# Autodesk Inventor assembly: montagem roda omni (adaptada)
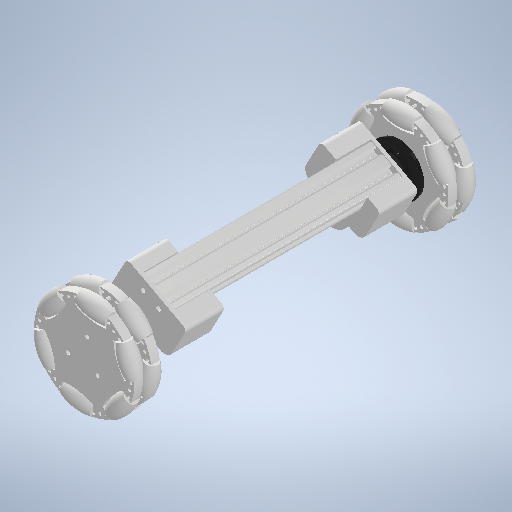
[picture p0: Inventor's stored thumbnail of the model, 512x512]
Saved by Autodesk Inventor 2025.2 (Build 292293000, 293)
## iProperties
Created: 2026-06-01
Part Number: montagem roda omni (adaptada)
Document SubType Name: Assembly
Designer: joaoc
Author: joaoc
## iProperties of the stored document Acoplamento motor roda V2.ipt
Created: 2025-01-07
Part Number: Acoplamento motor roda V2
Material: ABS Plastic
Document SubType Name: Modeling
Designer: Cliente
Mass: 17.616 g
Surface Area: 80.0658 cm^2
Volume: 19.1063 cm^3
Density: 0.922 g/cm^3
Appearance: Default
Sending System: Autodesk Inventor 2026
Author: Cliente
## iProperties of the stored document Mancal improvisado.ipt
Created: 2026-06-02
Part Number: Mancal improvisado
Material: Generic
Description: STEP AP203
Document SubType Name: Modeling
Designer: joaoc
Density: 1 g/cm^3
Appearance: Default
Sending System: SolidWorks 2023
Preprocessor: SwSTEP 2.0
Title: Mancal improvisado.STEP
Revision Number: ANY
## Documents named in this file (9)
- C:\Users\joaoc\Documents\montagem omnicare final\montagem roda omni (adaptada).iam
- C:\Users\joaoc\Documents\montagem omnicare final\Roda\roda 6.ipt
- **C:\Users\joaoc\Documents\montagem omnicare final\montagem roda omni (adaptada).iam*LocalDocs*xAaaaqadaAaaaaaaaAaaaaqfkYc*Acoplamento motor roda V2.ipt
- C:\Users\joaoc\Documents\montagem omnicare final\Perfil de alumínio\Perfil de alumínio.ipt
- C:\Users\joaoc\Documents\montagem omnicare final\rolamento\w_628_7_r-2z.iam
- **C:\Users\joaoc\Documents\montagem omnicare final\montagem roda omni (adaptada).iam*LocalDocs*xAaaaqedaAaaaaaaaAaaaq0lr5d*Mancal improvisado.ipt
- C:\Users\joaoc\Downloads\Eixo roda omni(1)\Eixo roda omni(1)\Eixo roda omni(1).ipt
- C:\Users\joaoc\Documents\montagem omnicare final\Roda\Acoplamento motor roda V2.ipt
- C:\Users\joaoc\Downloads\Mancal improvisado.STEP
## Components (13 placed, 6 different names)
1. Perfil de alumínio:1 — Mate:11, Mate:12, Mate:13, Mate:14, Mate:15, Mate:16
2. Mancal improvisado:1 — Insert:1, Insert:2, Mate:11, Mate:12, Mate:13
3. Mancal improvisado:2 — Insert:3, Insert:4, Mate:14, Mate:15, Mate:16, Cylindrical:4
4. Eixo roda omni(1):1 — Cylindrical:1, Insert:5, Cylindrical:4
5. Eixo roda omni(1):2 — Cylindrical:2, Insert:6, Cylindrical:3
6. w_628_7_r-2z:4 [sub-assembly] — Insert:4
7. w_628_7_r-2z:3 [sub-assembly] — Insert:3, Mate:18
8. Acoplamento motor roda V2:1 — Mate:1, Mate:2, Mate:3, Mate:17, Cylindrical:2, Insert:6, Mate:19
9. roda 6:1 — Mate:1, Mate:2, Mate:3
10. w_628_7_r-2z:2 [sub-assembly] — Insert:2, Mate:17, Cylindrical:3, Mate:19
11. w_628_7_r-2z:1 [sub-assembly] — Insert:1
12. roda 6:2 — Mate:4, Mate:5, Mate:6
13. Acoplamento motor roda V2:2 — Mate:4, Mate:5, Mate:6, Mate:18, Cylindrical:1, Insert:5
## Relationships (25: Mate 15, Insert 6, CylindricalJoint 4)
- Mate:1: Acoplamento motor roda V2:1 ↔ roda 6:1
- Mate:2: Acoplamento motor roda V2:1 ↔ roda 6:1
- Mate:3: Acoplamento motor roda V2:1 ↔ roda 6:1
- Mate:4: roda 6:2 ↔ Acoplamento motor roda V2:2
- Mate:5: roda 6:2 ↔ Acoplamento motor roda V2:2
- Mate:6: roda 6:2 ↔ Acoplamento motor roda V2:2
- Insert:1: Mancal improvisado:1 ↔ w_628_7_r-2z:1
- Insert:2: Mancal improvisado:1 ↔ w_628_7_r-2z:2
- Insert:3: Mancal improvisado:2 ↔ w_628_7_r-2z:3
- Insert:4: Mancal improvisado:2 ↔ w_628_7_r-2z:4
- Mate:11: Perfil de alumínio:1 ↔ Mancal improvisado:1
- Mate:12: Perfil de alumínio:1 ↔ Mancal improvisado:1
- Mate:13: Perfil de alumínio:1 ↔ Mancal improvisado:1
- Mate:14: Perfil de alumínio:1 ↔ Mancal improvisado:2
- Mate:15: Perfil de alumínio:1 ↔ Mancal improvisado:2
- Mate:16: Perfil de alumínio:1 ↔ Mancal improvisado:2
- Mate:17 (5 mm): Acoplamento motor roda V2:1 ↔ w_628_7_r-2z:2
- Mate:18 (5 mm): w_628_7_r-2z:3 ↔ Acoplamento motor roda V2:2
- Cylindrical:1: Eixo roda omni(1):1 ↔ Acoplamento motor roda V2:2
- Insert:5: Eixo roda omni(1):1 ↔ Acoplamento motor roda V2:2
- Cylindrical:2: Eixo roda omni(1):2 ↔ Acoplamento motor roda V2:1
- Insert:6: Eixo roda omni(1):2 ↔ Acoplamento motor roda V2:1
- Cylindrical:3: Eixo roda omni(1):2 ↔ w_628_7_r-2z:2
- Mate:19: Acoplamento motor roda V2:1 ↔ w_628_7_r-2z:2
- Cylindrical:4: Mancal improvisado:2 ↔ Eixo roda omni(1):1
